# Autodesk Inventor assembly: ASSEMBLY_DUT_Ant_Rotator_REVB
(part 3 of 5)
- Mate:91: 3DP_PLA_A_Axis_Stepper_Mount_REVB:1 ↔ DIN 934 - replaced by DIN EN 24032/28673/28674 M4:10
- Mate:92: 3DP_PLA_A_Axis_Bearing_Base:1 ↔ DIN 934 - replaced by DIN EN 24032/28673/28674 M4:10
- Mate:93: 3DP_PLA_A_Axis_Stepper_Mount_REVB:1 ↔ DIN 934 - replaced by DIN EN 24032/28673/28674 M4:11
- Mate:94: 3DP_PLA_A_Axis_Bearing_Base:1 ↔ DIN 934 - replaced by DIN EN 24032/28673/28674 M4:11
- Angle:18 (0 deg): 3DP_PLA_A_Axis_Bearing_Base:1 ↔ DIN 934 - replaced by DIN EN 24032/28673/28674 M4:9
- Angle:19 (0 deg): 3DP_PLA_A_Axis_Bearing_Base:1 ↔ DIN 934 - replaced by DIN EN 24032/28673/28674 M4:10
- Angle:20 (0 deg): 3DP_PLA_A_Axis_Bearing_Base:1 ↔ DIN 934 - replaced by DIN EN 24032/28673/28674 M4:11
- Mate:95: 3DP_PLA_A_Axis_Stepper_Mount_REVB:1 ↔ ASSEMBLY_HTD3M_Idler_A_Axis:2
- Mate:96: 3DP_PLA_A_Axis_Stepper_Mount_REVB:1 ↔ ASSEMBLY_HTD3M_Idler_A_Axis:1
- Mate:97: 3DP_PLA_A_Axis_Stepper_Mount_REVB:1 ↔ ASSEMBLY_HTD3M_Idler_A_Axis:2
- Mate:98: 3DP_PLA_A_Axis_Stepper_Mount_REVB:1 ↔ ASSEMBLY_HTD3M_Idler_A_Axis:1
- Mate:107: COTS_MKS_SERVO42D_40mm:1 ↔ 3DP_PLA_A_Axis_Stepper_Mount_REVB:1
- Mate:108 (1.6 mm): COTS_MKS_SERVO42D_40mm:1 ↔ 3DP_PLA_A_Axis_Stepper_Mount_REVB:1
- Mate:109 (1.6 mm): COTS_MKS_SERVO42D_40mm:1 ↔ 3DP_PLA_A_Axis_Stepper_Mount_REVB:1
- Mate:110: COTS_MKS_SERVO42D_40mm:1 ↔ DIN 125-1 A A 3,2:1
- Mate:111: 3DP_PLA_A_Axis_Stepper_Mount_REVB:1 ↔ DIN 125-1 A A 3,2:1
- Mate:112: COTS_MKS_SERVO42D_40mm:1 ↔ DIN 125-1 A A 3,2:2
- Mate:113: 3DP_PLA_A_Axis_Stepper_Mount_REVB:1 ↔ DIN 125-1 A A 3,2:2
- Mate:114: COTS_MKS_SERVO42D_40mm:1 ↔ DIN 125-1 A A 3,2:3
- Mate:115: 3DP_PLA_A_Axis_Stepper_Mount_REVB:1 ↔ DIN 125-1 A A 3,2:3
- Mate:116: COTS_MKS_SERVO42D_40mm:1 ↔ DIN 125-1 A A 3,2:4
- Mate:117: 3DP_PLA_A_Axis_Stepper_Mount_REVB:1 ↔ DIN 125-1 A A 3,2:4
- Insert:1: ISO 7380-1 M3 x 16:1 ↔ DIN 125-1 A A 3,2:1
- Insert:2: ISO 7380-1 M3 x 16:2 ↔ DIN 125-1 A A 3,2:2
- Insert:3: ISO 7380-1 M3 x 16:3 ↔ DIN 125-1 A A 3,2:3
- Insert:4: ISO 7380-1 M3 x 16:4 ↔ DIN 125-1 A A 3,2:4
- Mate:118: COTS_GENERIC_HTD3M_24T_6mm_5mm_shaft_pulley:1 ↔ COTS_GENERIC_HTD3M_6mm_675mm_Closed_belt_A_Axis:1
- Mate:119 (0.5 mm): COTS_GENERIC_HTD3M_24T_6mm_5mm_shaft_pulley:1 ↔ COTS_GENERIC_HTD3M_6mm_675mm_Closed_belt_A_Axis:1
- Mate:121: 3DP_PLA_A_Axis_Rotating_Stage:1 ↔ 3DP_PLA_A_Axis_Rotating_Stage_Fiberglass_pipes_mount_plate:1
- Mate:122: 3DP_PLA_A_Axis_Rotating_Stage:1 ↔ 3DP_PLA_A_Axis_Rotating_Stage_Fiberglass_pipes_mount_plate:1
- Mate:123: 3DP_PLA_A_Axis_Rotating_Stage:1 ↔ 3DP_PLA_A_Axis_Rotating_Stage_Fiberglass_pipes_mount_plate:1
- Mate:124: COTS_CARBONCENTER_Fiberglass_Tube_27x24x383mm:1 ↔ 3DP_PLA_A_Axis_Rotating_Stage_Fiberglass_pipes_mount_plate:1
- Flush:1: COTS_CARBONCENTER_Fiberglass_Tube_27x24x383mm:1 ↔ 3DP_PLA_A_Axis_Rotating_Stage_Fiberglass_pipes_mount_plate:1
- Mate:125: 3DP_PLA_A_Axis_Rotating_Stage_Fiberglass_pipes_mount_plate:1 ↔ COTS_CARBONCENTER_Fiberglass_Tube_27x24x383mm:2
- Flush:2: 3DP_PLA_A_Axis_Rotating_Stage_Fiberglass_pipes_mount_plate:1 ↔ COTS_CARBONCENTER_Fiberglass_Tube_27x24x383mm:2
- Mate:127 (1 mm): 3DP_PLA_A_Axis_Rotating_Stage_Fiberglass_pipes_mount_plate:1 ↔ 3DP_PLA_A_Axis_Rotating_Stage_Fiberglass_pipes_mount_clamp:2
- Mate:128 (1 mm): 3DP_PLA_A_Axis_Rotating_Stage_Fiberglass_pipes_mount_plate:1 ↔ 3DP_PLA_A_Axis_Rotating_Stage_Fiberglass_pipes_mount_clamp:1
- Flush:3: 3DP_PLA_A_Axis_Rotating_Stage_Fiberglass_pipes_mount_plate:1 ↔ 3DP_PLA_A_Axis_Rotating_Stage_Fiberglass_pipes_mount_clamp:2
- Flush:4: 3DP_PLA_A_Axis_Rotating_Stage_Fiberglass_pipes_mount_plate:1 ↔ 3DP_PLA_A_Axis_Rotating_Stage_Fiberglass_pipes_mount_clamp:2
- Flush:5: 3DP_PLA_A_Axis_Rotating_Stage_Fiberglass_pipes_mount_plate:1 ↔ 3DP_PLA_A_Axis_Rotating_Stage_Fiberglass_pipes_mount_clamp:1
- Flush:6: 3DP_PLA_A_Axis_Rotating_Stage_Fiberglass_pipes_mount_plate:1 ↔ 3DP_PLA_A_Axis_Rotating_Stage_Fiberglass_pipes_mount_clamp:1
- Mate:129: 3DP_PLA_A_Axis_Rotating_Stage_Fiberglass_pipes_mount_clamp:2 ↔ DIN 912 - replaced by DIN EN ISO 4762 M5 x 50:9
- Mate:130: 3DP_PLA_A_Axis_Rotating_Stage_Fiberglass_pipes_mount_clamp:2 ↔ DIN 912 - replaced by DIN EN ISO 4762 M5 x 50:9
- Mate:131: 3DP_PLA_A_Axis_Rotating_Stage_Fiberglass_pipes_mount_clamp:2 ↔ DIN 912 - replaced by DIN EN ISO 4762 M5 x 50:10
- Mate:132: 3DP_PLA_A_Axis_Rotating_Stage_Fiberglass_pipes_mount_clamp:2 ↔ DIN 912 - replaced by DIN EN ISO 4762 M5 x 50:10
- Mate:133: 3DP_PLA_A_Axis_Rotating_Stage_Fiberglass_pipes_mount_clamp:2 ↔ DIN 912 - replaced by DIN EN ISO 4762 M5 x 50:11
- Mate:134: 3DP_PLA_A_Axis_Rotating_Stage_Fiberglass_pipes_mount_clamp:2 ↔ DIN 912 - replaced by DIN EN ISO 4762 M5 x 50:11
- Mate:135: 3DP_PLA_A_Axis_Rotating_Stage_Fiberglass_pipes_mount_clamp:2 ↔ DIN 912 - replaced by DIN EN ISO 4762 M5 x 50:12
- Mate:136: 3DP_PLA_A_Axis_Rotating_Stage_Fiberglass_pipes_mount_clamp:2 ↔ DIN 912 - replaced by DIN EN ISO 4762 M5 x 50:12
- Mate:137: 3DP_PLA_A_Axis_Rotating_Stage_Fiberglass_pipes_mount_clamp:2 ↔ DIN 912 - replaced by DIN EN ISO 4762 M5 x 50:13
- Mate:138: 3DP_PLA_A_Axis_Rotating_Stage_Fiberglass_pipes_mount_clamp:2 ↔ DIN 912 - replaced by DIN EN ISO 4762 M5 x 50:13
- Mate:139: 3DP_PLA_A_Axis_Rotating_Stage_Fiberglass_pipes_mount_clamp:2 ↔ DIN 912 - replaced by DIN EN ISO 4762 M5 x 50:14
- Mate:140: 3DP_PLA_A_Axis_Rotating_Stage_Fiberglass_pipes_mount_clamp:2 ↔ DIN 912 - replaced by DIN EN ISO 4762 M5 x 50:14
- Mate:141: 3DP_PLA_A_Axis_Rotating_Stage_Fiberglass_pipes_mount_clamp:1 ↔ DIN 912 - replaced by DIN EN ISO 4762 M5 x 50:15
- Mate:142: 3DP_PLA_A_Axis_Rotating_Stage_Fiberglass_pipes_mount_clamp:2 ↔ DIN 912 - replaced by DIN EN ISO 4762 M5 x 50:15
- Mate:143: 3DP_PLA_A_Axis_Rotating_Stage_Fiberglass_pipes_mount_clamp:1 ↔ DIN 912 - replaced by DIN EN ISO 4762 M5 x 50:16
- Mate:144: 3DP_PLA_A_Axis_Rotating_Stage_Fiberglass_pipes_mount_clamp:2 ↔ DIN 912 - replaced by DIN EN ISO 4762 M5 x 50:16
- Mate:145: 3DP_PLA_A_Axis_Rotating_Stage_Fiberglass_pipes_mount_clamp:1 ↔ DIN 912 - replaced by DIN EN ISO 4762 M5 x 50:17
- Mate:146: 3DP_PLA_A_Axis_Rotating_Stage_Fiberglass_pipes_mount_clamp:2 ↔ DIN 912 - replaced by DIN EN ISO 4762 M5 x 50:17
- Mate:147: 3DP_PLA_A_Axis_Rotating_Stage_Fiberglass_pipes_mount_clamp:1 ↔ DIN 912 - replaced by DIN EN ISO 4762 M5 x 50:18
- Mate:148: 3DP_PLA_A_Axis_Rotating_Stage_Fiberglass_pipes_mount_clamp:2 ↔ DIN 912 - replaced by DIN EN ISO 4762 M5 x 50:18
- Mate:149: 3DP_PLA_A_Axis_Rotating_Stage_Fiberglass_pipes_mount_clamp:1 ↔ DIN 912 - replaced by DIN EN ISO 4762 M5 x 50:19
- Mate:150: 3DP_PLA_A_Axis_Rotating_Stage_Fiberglass_pipes_mount_clamp:2 ↔ DIN 912 - replaced by DIN EN ISO 4762 M5 x 50:19
- Mate:151: 3DP_PLA_A_Axis_Rotating_Stage_Fiberglass_pipes_mount_clamp:1 ↔ DIN 912 - replaced by DIN EN ISO 4762 M5 x 50:20
- Mate:152: 3DP_PLA_A_Axis_Rotating_Stage_Fiberglass_pipes_mount_clamp:2 ↔ DIN 912 - replaced by DIN EN ISO 4762 M5 x 50:20
- Mate:153: 3DP_PLA_A_Axis_Rotating_Stage_Fiberglass_pipes_mount_clamp:2 ↔ DIN 934 - replaced by DIN EN 24032/28673/28674 M5:9
- Mate:154: 3DP_PLA_A_Axis_Rotating_Stage_Fiberglass_pipes_mount_plate:1 ↔ DIN 934 - replaced by DIN EN 24032/28673/28674 M5:9
- Mate:155: 3DP_PLA_A_Axis_Rotating_Stage_Fiberglass_pipes_mount_clamp:2 ↔ DIN 934 - replaced by DIN EN 24032/28673/28674 M5:10
- Mate:156: 3DP_PLA_A_Axis_Rotating_Stage_Fiberglass_pipes_mount_plate:1 ↔ DIN 934 - replaced by DIN EN 24032/28673/28674 M5:10
- Mate:157: 3DP_PLA_A_Axis_Rotating_Stage_Fiberglass_pipes_mount_clamp:2 ↔ DIN 934 - replaced by DIN EN 24032/28673/28674 M5:11
- Mate:158: 3DP_PLA_A_Axis_Rotating_Stage_Fiberglass_pipes_mount_plate:1 ↔ DIN 934 - replaced by DIN EN 24032/28673/28674 M5:11
- Mate:159: 3DP_PLA_A_Axis_Rotating_Stage_Fiberglass_pipes_mount_clamp:2 ↔ DIN 934 - replaced by DIN EN 24032/28673/28674 M5:12
- Mate:160: 3DP_PLA_A_Axis_Rotating_Stage_Fiberglass_pipes_mount_plate:1 ↔ DIN 934 - replaced by DIN EN 24032/28673/28674 M5:12
- Mate:161: 3DP_PLA_A_Axis_Rotating_Stage_Fiberglass_pipes_mount_clamp:2 ↔ DIN 934 - replaced by DIN EN 24032/28673/28674 M5:13
- Mate:162: 3DP_PLA_A_Axis_Rotating_Stage_Fiberglass_pipes_mount_plate:1 ↔ DIN 934 - replaced by DIN EN 24032/28673/28674 M5:13
- Mate:163: 3DP_PLA_A_Axis_Rotating_Stage_Fiberglass_pipes_mount_clamp:2 ↔ DIN 934 - replaced by DIN EN 24032/28673/28674 M5:14
- Mate:164: 3DP_PLA_A_Axis_Rotating_Stage_Fiberglass_pipes_mount_plate:1 ↔ DIN 934 - replaced by DIN EN 24032/28673/28674 M5:14
- Mate:165: 3DP_PLA_A_Axis_Rotating_Stage_Fiberglass_pipes_mount_clamp:1 ↔ DIN 934 - replaced by DIN EN 24032/28673/28674 M5:15
- Mate:166: 3DP_PLA_A_Axis_Rotating_Stage_Fiberglass_pipes_mount_plate:1 ↔ DIN 934 - replaced by DIN EN 24032/28673/28674 M5:15
- Mate:167: 3DP_PLA_A_Axis_Rotating_Stage_Fiberglass_pipes_mount_clamp:1 ↔ DIN 934 - replaced by DIN EN 24032/28673/28674 M5:16
- Mate:168: 3DP_PLA_A_Axis_Rotating_Stage_Fiberglass_pipes_mount_plate:1 ↔ DIN 934 - replaced by DIN EN 24032/28673/28674 M5:16
- Mate:169: 3DP_PLA_A_Axis_Rotating_Stage_Fiberglass_pipes_mount_clamp:1 ↔ DIN 934 - replaced by DIN EN 24032/28673/28674 M5:17
- Mate:170: 3DP_PLA_A_Axis_Rotating_Stage_Fiberglass_pipes_mount_plate:1 ↔ DIN 934 - replaced by DIN EN 24032/28673/28674 M5:17
- Mate:171: 3DP_PLA_A_Axis_Rotating_Stage_Fiberglass_pipes_mount_clamp:1 ↔ DIN 934 - replaced by DIN EN 24032/28673/28674 M5:18
- Mate:172: 3DP_PLA_A_Axis_Rotating_Stage_Fiberglass_pipes_mount_plate:1 ↔ DIN 934 - replaced by DIN EN 24032/28673/28674 M5:18
- Mate:173: 3DP_PLA_A_Axis_Rotating_Stage_Fiberglass_pipes_mount_clamp:1 ↔ DIN 934 - replaced by DIN EN 24032/28673/28674 M5:19
- Mate:174: 3DP_PLA_A_Axis_Rotating_Stage_Fiberglass_pipes_mount_plate:1 ↔ DIN 934 - replaced by DIN EN 24032/28673/28674 M5:19
- Mate:175: 3DP_PLA_A_Axis_Rotating_Stage_Fiberglass_pipes_mount_clamp:1 ↔ DIN 934 - replaced by DIN EN 24032/28673/28674 M5:20
- Mate:176: 3DP_PLA_A_Axis_Rotating_Stage_Fiberglass_pipes_mount_plate:1 ↔ DIN 934 - replaced by DIN EN 24032/28673/28674 M5:20
- Angle:21 (0 deg): 3DP_PLA_A_Axis_Rotating_Stage_Fiberglass_pipes_mount_plate:1 ↔ DIN 934 - replaced by DIN EN 24032/28673/28674 M5:9
- Angle:22 (0 deg): 3DP_PLA_A_Axis_Rotating_Stage_Fiberglass_pipes_mount_plate:1 ↔ DIN 934 - replaced by DIN EN 24032/28673/28674 M5:12
- Angle:23 (0 deg): 3DP_PLA_A_Axis_Rotating_Stage_Fiberglass_pipes_mount_plate:1 ↔ DIN 934 - replaced by DIN EN 24032/28673/28674 M5:13
- Angle:24 (0 deg): 3DP_PLA_A_Axis_Rotating_Stage_Fiberglass_pipes_mount_plate:1 ↔ DIN 934 - replaced by DIN EN 24032/28673/28674 M5:14
- Angle:25 (0 deg): 3DP_PLA_A_Axis_Rotating_Stage_Fiberglass_pipes_mount_plate:1 ↔ DIN 934 - replaced by DIN EN 24032/28673/28674 M5:11
- Angle:26 (0 deg): 3DP_PLA_A_Axis_Rotating_Stage_Fiberglass_pipes_mount_plate:1 ↔ DIN 934 - replaced by DIN EN 24032/28673/28674 M5:10
- Angle:27 (0 deg): 3DP_PLA_A_Axis_Rotating_Stage_Fiberglass_pipes_mount_plate:1 ↔ DIN 934 - replaced by DIN EN 24032/28673/28674 M5:20
- Angle:28 (0 deg): 3DP_PLA_A_Axis_Rotating_Stage_Fiberglass_pipes_mount_plate:1 ↔ DIN 934 - replaced by DIN EN 24032/28673/28674 M5:19
- Angle:29 (0 deg): 3DP_PLA_A_Axis_Rotating_Stage_Fiberglass_pipes_mount_plate:1 ↔ DIN 934 - replaced by DIN EN 24032/28673/28674 M5:18
- Angle:30 (0 deg): 3DP_PLA_A_Axis_Rotating_Stage_Fiberglass_pipes_mount_plate:1 ↔ DIN 934 - replaced by DIN EN 24032/28673/28674 M5:17
- Angle:31 (0 deg): 3DP_PLA_A_Axis_Rotating_Stage_Fiberglass_pipes_mount_plate:1 ↔ DIN 934 - replaced by DIN EN 24032/28673/28674 M5:16
- Angle:32 (0 deg): 3DP_PLA_A_Axis_Rotating_Stage_Fiberglass_pipes_mount_plate:1 ↔ DIN 934 - replaced by DIN EN 24032/28673/28674 M5:15
- Mate:177: 3DP_PLA_A_Axis_Rotating_Stage_Fiberglass_pipes_mount_plate:1 ↔ DIN 912 - replaced by DIN EN ISO 4762 M4 x 20:1
- Mate:178: 3DP_PLA_A_Axis_Rotating_Stage_Fiberglass_pipes_mount_plate:1 ↔ DIN 912 - replaced by DIN EN ISO 4762 M4 x 20:1
- Mate:179: 3DP_PLA_A_Axis_Rotating_Stage_Fiberglass_pipes_mount_plate:1 ↔ DIN 912 - replaced by DIN EN ISO 4762 M4 x 20:2
- Mate:180: 3DP_PLA_A_Axis_Rotating_Stage_Fiberglass_pipes_mount_plate:1 ↔ DIN 912 - replaced by DIN EN ISO 4762 M4 x 20:2
- Mate:181: 3DP_PLA_A_Axis_Rotating_Stage_Fiberglass_pipes_mount_plate:1 ↔ DIN 912 - replaced by DIN EN ISO 4762 M4 x 20:3
- Mate:182: 3DP_PLA_A_Axis_Rotating_Stage_Fiberglass_pipes_mount_plate:1 ↔ DIN 912 - replaced by DIN EN ISO 4762 M4 x 20:3
- Mate:183: 3DP_PLA_A_Axis_Rotating_Stage_Fiberglass_pipes_mount_plate:1 ↔ DIN 912 - replaced by DIN EN ISO 4762 M4 x 20:4
- Mate:184: 3DP_PLA_A_Axis_Rotating_Stage_Fiberglass_pipes_mount_plate:1 ↔ DIN 912 - replaced by DIN EN ISO 4762 M4 x 20:4
- Mate:185: 3DP_PLA_A_Axis_Rotating_Stage_Fiberglass_pipes_mount_plate:1 ↔ DIN 912 - replaced by DIN EN ISO 4762 M4 x 20:5
- Mate:186: 3DP_PLA_A_Axis_Rotating_Stage_Fiberglass_pipes_mount_plate:1 ↔ DIN 912 - replaced by DIN EN ISO 4762 M4 x 20:5
- Mate:187: 3DP_PLA_A_Axis_Rotating_Stage_Fiberglass_pipes_mount_plate:1 ↔ DIN 912 - replaced by DIN EN ISO 4762 M4 x 20:6
- Mate:188: 3DP_PLA_A_Axis_Rotating_Stage_Fiberglass_pipes_mount_plate:1 ↔ DIN 912 - replaced by DIN EN ISO 4762 M4 x 20:6
- Mate:189: 3DP_PLA_A_Axis_Rotating_Stage_Fiberglass_pipes_mount_plate:1 ↔ DIN 912 - replaced by DIN EN ISO 4762 M4 x 20:7
- Mate:190: 3DP_PLA_A_Axis_Rotating_Stage_Fiberglass_pipes_mount_plate:1 ↔ DIN 912 - replaced by DIN EN ISO 4762 M4 x 20:7
- Mate:191: 3DP_PLA_A_Axis_Rotating_Stage_Fiberglass_pipes_mount_plate:1 ↔ DIN 912 - replaced by DIN EN ISO 4762 M4 x 20:8
- Mate:192: 3DP_PLA_A_Axis_Rotating_Stage_Fiberglass_pipes_mount_plate:1 ↔ DIN 912 - replaced by DIN EN ISO 4762 M4 x 20:8
- Mate:193: 3DP_PLA_A_Axis_Rotating_Stage_Fiberglass_pipes_mount_plate:1 ↔ DIN 934 - replaced by DIN EN 24032/28673/28674 M4:14
- Mate:194: 3DP_PLA_A_Axis_Rotating_Stage:1 ↔ DIN 934 - replaced by DIN EN 24032/28673/28674 M4:14
- Mate:195: 3DP_PLA_A_Axis_Rotating_Stage_Fiberglass_pipes_mount_plate:1 ↔ DIN 934 - replaced by DIN EN 24032/28673/28674 M4:15
- Mate:196: 3DP_PLA_A_Axis_Rotating_Stage:1 ↔ DIN 934 - replaced by DIN EN 24032/28673/28674 M4:15
- Mate:197: 3DP_PLA_A_Axis_Rotating_Stage_Fiberglass_pipes_mount_plate:1 ↔ DIN 934 - replaced by DIN EN 24032/28673/28674 M4:16
- Mate:198: 3DP_PLA_A_Axis_Rotating_Stage:1 ↔ DIN 934 - replaced by DIN EN 24032/28673/28674 M4:16
- Mate:199: 3DP_PLA_A_Axis_Rotating_Stage_Fiberglass_pipes_mount_plate:1 ↔ DIN 934 - replaced by DIN EN 24032/28673/28674 M4:17
- Mate:200: 3DP_PLA_A_Axis_Rotating_Stage:1 ↔ DIN 934 - replaced by DIN EN 24032/28673/28674 M4:17
- Mate:201: 3DP_PLA_A_Axis_Rotating_Stage_Fiberglass_pipes_mount_plate:1 ↔ DIN 934 - replaced by DIN EN 24032/28673/28674 M4:18
- Mate:202: 3DP_PLA_A_Axis_Rotating_Stage:1 ↔ DIN 934 - replaced by DIN EN 24032/28673/28674 M4:18
- Mate:203: 3DP_PLA_A_Axis_Rotating_Stage_Fiberglass_pipes_mount_plate:1 ↔ DIN 934 - replaced by DIN EN 24032/28673/28674 M4:19
- Mate:204: 3DP_PLA_A_Axis_Rotating_Stage:1 ↔ DIN 934 - replaced by DIN EN 24032/28673/28674 M4:19
- Mate:205: 3DP_PLA_A_Axis_Rotating_Stage_Fiberglass_pipes_mount_plate:1 ↔ DIN 934 - replaced by DIN EN 24032/28673/28674 M4:20
- Mate:206: 3DP_PLA_A_Axis_Rotating_Stage:1 ↔ DIN 934 - replaced by DIN EN 24032/28673/28674 M4:20
- Mate:207: 3DP_PLA_A_Axis_Rotating_Stage_Fiberglass_pipes_mount_plate:1 ↔ DIN 934 - replaced by DIN EN 24032/28673/28674 M4:21
- Mate:208: 3DP_PLA_A_Axis_Rotating_Stage:1 ↔ DIN 934 - replaced by DIN EN 24032/28673/28674 M4:21
- Angle:33 (0 deg): 3DP_PLA_A_Axis_Rotating_Stage:1 ↔ DIN 934 - replaced by DIN EN 24032/28673/28674 M4:17
- Angle:34 (0 deg): 3DP_PLA_A_Axis_Rotating_Stage:1 ↔ DIN 934 - replaced by DIN EN 24032/28673/28674 M4:15
- Angle:35 (0 deg): 3DP_PLA_A_Axis_Rotating_Stage:1 ↔ DIN 934 - replaced by DIN EN 24032/28673/28674 M4:14
- Angle:36 (0 deg): 3DP_PLA_A_Axis_Rotating_Stage:1 ↔ DIN 934 - replaced by DIN EN 24032/28673/28674 M4:16
- Angle:37 (0 deg): 3DP_PLA_A_Axis_Rotating_Stage:1 ↔ DIN 934 - replaced by DIN EN 24032/28673/28674 M4:21
- Angle:38 (0 deg): 3DP_PLA_A_Axis_Rotating_Stage:1 ↔ DIN 934 - replaced by DIN EN 24032/28673/28674 M4:20
- Angle:39 (0 deg): 3DP_PLA_A_Axis_Rotating_Stage:1 ↔ DIN 934 - replaced by DIN EN 24032/28673/28674 M4:19
- Angle:40 (0 deg): 3DP_PLA_A_Axis_Rotating_Stage:1 ↔ DIN 934 - replaced by DIN EN 24032/28673/28674 M4:18
- Angle:41 (0 deg): 3DP_PLA_A_Axis_Rotating_Stage_Fiberglass_pipes_mount_plate:1
- Mate:209: COTS_CARBONCENTER_Fiberglass_Tube_27x24x383mm:2 ↔ 3DP_PLA_Fiberglass_Pipe_Corner_Bracket:1
- Mate:210: COTS_CARBONCENTER_Fiberglass_Tube_27x24x383mm:1 ↔ 3DP_PLA_Fiberglass_Pipe_Corner_Bracket:1
- Mate:211: COTS_CARBONCENTER_Fiberglass_Tube_27x24x383mm:3 ↔ 3DP_PLA_Fiberglass_Pipe_Corner_Bracket:1
- Mate:212: COTS_CARBONCENTER_Fiberglass_Tube_27x24x383mm:4 ↔ 3DP_PLA_Fiberglass_Pipe_Corner_Bracket:1
- Mate:213: COTS_CARBONCENTER_Fiberglass_Tube_27x24x383mm:2 ↔ 3DP_PLA_Fiberglass_Pipe_Corner_Bracket_Clamp:1
- Mate:214: COTS_CARBONCENTER_Fiberglass_Tube_27x24x383mm:1 ↔ 3DP_PLA_Fiberglass_Pipe_Corner_Bracket_Clamp:1
- Mate:215: 3DP_PLA_Fiberglass_Pipe_Corner_Bracket:1 ↔ 3DP_PLA_Fiberglass_Pipe_Corner_Bracket_Clamp:1
- Mate:216: 3DP_PLA_Fiberglass_Pipe_Corner_Bracket_Clamp:1 ↔ COTS_DREMEC_8G206M6X50_M6x50_Nylon_Screw:3
- Mate:217: 3DP_PLA_Fiberglass_Pipe_Corner_Bracket_Clamp:1 ↔ COTS_DREMEC_8G206M6X50_M6x50_Nylon_Screw:1
- Mate:218: 3DP_PLA_Fiberglass_Pipe_Corner_Bracket_Clamp:1 ↔ COTS_DREMEC_8G206M6X50_M6x50_Nylon_Screw:2
- Mate:219: 3DP_PLA_Fiberglass_Pipe_Corner_Bracket_Clamp:1 ↔ COTS_DREMEC_8G206M6X50_M6x50_Nylon_Screw:4
- Mate:220: 3DP_PLA_Fiberglass_Pipe_Corner_Bracket_Clamp:1 ↔ COTS_DREMEC_8G206M6X50_M6x50_Nylon_Screw:5
- Mate:221: 3DP_PLA_Fiberglass_Pipe_Corner_Bracket_Clamp:1 ↔ COTS_DREMEC_8G206M6X50_M6x50_Nylon_Screw:6
- Mate:222: 3DP_PLA_Fiberglass_Pipe_Corner_Bracket_Clamp:1 ↔ COTS_DREMEC_8G206M6X50_M6x50_Nylon_Screw:1
- Mate:223: 3DP_PLA_Fiberglass_Pipe_Corner_Bracket_Clamp:1 ↔ COTS_DREMEC_8G206M6X50_M6x50_Nylon_Screw:3
- Mate:224: 3DP_PLA_Fiberglass_Pipe_Corner_Bracket_Clamp:1 ↔ COTS_DREMEC_8G206M6X50_M6x50_Nylon_Screw:2
- Mate:225: 3DP_PLA_Fiberglass_Pipe_Corner_Bracket_Clamp:1 ↔ COTS_DREMEC_8G206M6X50_M6x50_Nylon_Screw:4
- Mate:226: 3DP_PLA_Fiberglass_Pipe_Corner_Bracket_Clamp:1 ↔ COTS_DREMEC_8G206M6X50_M6x50_Nylon_Screw:5
- Mate:227: 3DP_PLA_Fiberglass_Pipe_Corner_Bracket_Clamp:1 ↔ COTS_DREMEC_8G206M6X50_M6x50_Nylon_Screw:6
- Flush:7: COTS_CARBONCENTER_Fiberglass_Tube_27x24x383mm:2 ↔ 3DP_PLA_Fiberglass_Pipe_Corner_Bracket_Clamp:1
- Mate:228: 3DP_PLA_Fiberglass_Pipe_Corner_Bracket:1 ↔ COTS_BOSSARD_1400444_M6_Nylon_Nut:1
- Mate:229: 3DP_PLA_Fiberglass_Pipe_Corner_Bracket:1 ↔ COTS_BOSSARD_1400444_M6_Nylon_Nut:2
- Mate:230: 3DP_PLA_Fiberglass_Pipe_Corner_Bracket:1 ↔ COTS_BOSSARD_1400444_M6_Nylon_Nut:5
- Mate:231: 3DP_PLA_Fiberglass_Pipe_Corner_Bracket:1 ↔ COTS_BOSSARD_1400444_M6_Nylon_Nut:4
- Mate:232: 3DP_PLA_Fiberglass_Pipe_Corner_Bracket:1 ↔ COTS_BOSSARD_1400444_M6_Nylon_Nut:3
- Mate:233: 3DP_PLA_Fiberglass_Pipe_Corner_Bracket:1 ↔ COTS_BOSSARD_1400444_M6_Nylon_Nut:6
- Mate:234: COTS_BOSSARD_1400444_M6_Nylon_Nut:1 ↔ COTS_DREMEC_8G206M6X50_M6x50_Nylon_Screw:3
- Mate:235: COTS_BOSSARD_1400444_M6_Nylon_Nut:2 ↔ COTS_DREMEC_8G206M6X50_M6x50_Nylon_Screw:1
- Mate:236: COTS_BOSSARD_1400444_M6_Nylon_Nut:4 ↔ COTS_DREMEC_8G206M6X50_M6x50_Nylon_Screw:4
- Mate:237: COTS_BOSSARD_1400444_M6_Nylon_Nut:5 ↔ COTS_DREMEC_8G206M6X50_M6x50_Nylon_Screw:2
- Mate:238: COTS_BOSSARD_1400444_M6_Nylon_Nut:3 ↔ COTS_DREMEC_8G206M6X50_M6x50_Nylon_Screw:5
- Mate:239: COTS_BOSSARD_1400444_M6_Nylon_Nut:6 ↔ COTS_DREMEC_8G206M6X50_M6x50_Nylon_Screw:6
- Mate:240 (-83.25 mm): COTS_CARBONCENTER_Fiberglass_Tube_27x24x383mm:3 ↔ 3DP_PLA_Fiberglass_Pipe_Corner_Bracket:1
- Mate:241 (-83.25 mm): COTS_CARBONCENTER_Fiberglass_Tube_27x24x383mm:4 ↔ 3DP_PLA_Fiberglass_Pipe_Corner_Bracket:1
- Mate:242: COTS_CARBONCENTER_Fiberglass_Tube_27x24x383mm:3 ↔ 3DP_PLA_Fiberglass_Pipe_Corner_Bracket_Clamp_and_B_axis_Stepper_Mount_REVB:1
- Mate:243: COTS_CARBONCENTER_Fiberglass_Tube_27x24x383mm:4 ↔ 3DP_PLA_Fiberglass_Pipe_Corner_Bracket_Clamp_and_B_axis_Stepper_Mount_REVB:1
- Mate:244: 3DP_PLA_Fiberglass_Pipe_Corner_Bracket:1 ↔ 3DP_PLA_Fiberglass_Pipe_Corner_Bracket_Clamp_and_B_axis_Stepper_Mount_REVB:1
- Mate:245: 3DP_PLA_Fiberglass_Pipe_Corner_Bracket_Clamp_and_B_axis_Stepper_Mount_REVB:1 ↔ COTS_MKS_SERVO42D_40mm:2
- Mate:247: COTS_MKS_SERVO42D_40mm:2 ↔ COTS_GENERIC_HTD3M_20T_6mm_5mm_shaft_pulley:1
- Mate:248 (1.6 mm): 3DP_PLA_Fiberglass_Pipe_Corner_Bracket_Clamp_and_B_axis_Stepper_Mount_REVB:1 ↔ COTS_MKS_SERVO42D_40mm:2
- Mate:249 (1.6 mm): 3DP_PLA_Fiberglass_Pipe_Corner_Bracket_Clamp_and_B_axis_Stepper_Mount_REVB:1 ↔ COTS_MKS_SERVO42D_40mm:2
- Flush:8 (-11.5 mm): 3DP_PLA_Fiberglass_Pipe_Corner_Bracket_Clamp_and_B_axis_Stepper_Mount_REVB:1 ↔ COTS_GENERIC_HTD3M_20T_6mm_5mm_shaft_pulley:1
- Mate:250: COTS_CARBONCENTER_Fiberglass_Tube_27x24x383mm:6 ↔ 3DP_PLA_Fiberglass_Pipe_Corner_Bracket:2
- Mate:251: COTS_CARBONCENTER_Fiberglass_Tube_27x24x383mm:5 ↔ 3DP_PLA_Fiberglass_Pipe_Corner_Bracket:2
- Mate:252: COTS_CARBONCENTER_Fiberglass_Tube_27x24x383mm:8 ↔ 3DP_PLA_Fiberglass_Pipe_Corner_Bracket:2
- Mate:253: COTS_CARBONCENTER_Fiberglass_Tube_27x24x383mm:7 ↔ 3DP_PLA_Fiberglass_Pipe_Corner_Bracket:2
- Mate:254: COTS_CARBONCENTER_Fiberglass_Tube_27x24x383mm:5 ↔ 3DP_PLA_Fiberglass_Pipe_Corner_Bracket_Clamp:2
- Mate:255: COTS_CARBONCENTER_Fiberglass_Tube_27x24x383mm:6 ↔ 3DP_PLA_Fiberglass_Pipe_Corner_Bracket_Clamp:2
- Mate:256: COTS_CARBONCENTER_Fiberglass_Tube_27x24x383mm:7 ↔ 3DP_PLA_Fiberglass_Pipe_Corner_Bracket_Clamp:3
- Mate:257: COTS_CARBONCENTER_Fiberglass_Tube_27x24x383mm:8 ↔ 3DP_PLA_Fiberglass_Pipe_Corner_Bracket_Clamp:3
- Flush:9: 3DP_PLA_Fiberglass_Pipe_Corner_Bracket:2 ↔ 3DP_PLA_Fiberglass_Pipe_Corner_Bracket_Clamp:3
- Flush:10: 3DP_PLA_Fiberglass_Pipe_Corner_Bracket:2 ↔ 3DP_PLA_Fiberglass_Pipe_Corner_Bracket_Clamp:2
- Flush:11: COTS_CARBONCENTER_Fiberglass_Tube_27x24x383mm:5 ↔ 3DP_PLA_Fiberglass_Pipe_Corner_Bracket_Clamp:2
- Flush:12: COTS_CARBONCENTER_Fiberglass_Tube_27x24x383mm:6 ↔ 3DP_PLA_Fiberglass_Pipe_Corner_Bracket_Clamp:2
- Flush:13: COTS_CARBONCENTER_Fiberglass_Tube_27x24x383mm:7 ↔ 3DP_PLA_Fiberglass_Pipe_Corner_Bracket_Clamp:3
- Flush:14: COTS_CARBONCENTER_Fiberglass_Tube_27x24x383mm:8 ↔ 3DP_PLA_Fiberglass_Pipe_Corner_Bracket_Clamp:3
- Mate:258: 3DP_PLA_Fiberglass_Pipe_Corner_Bracket_Clamp_and_B_axis_Stepper_Mount_REVB:1 ↔ COTS_DREMEC_8G206M6X50_M6x50_Nylon_Screw:7
- Mate:259: 3DP_PLA_Fiberglass_Pipe_Corner_Bracket_Clamp_and_B_axis_Stepper_Mount_REVB:1 ↔ COTS_DREMEC_8G206M6X50_M6x50_Nylon_Screw:8
- Mate:260: 3DP_PLA_Fiberglass_Pipe_Corner_Bracket_Clamp_and_B_axis_Stepper_Mount_REVB:1 ↔ COTS_DREMEC_8G206M6X50_M6x50_Nylon_Screw:9
- Mate:261: 3DP_PLA_Fiberglass_Pipe_Corner_Bracket_Clamp_and_B_axis_Stepper_Mount_REVB:1 ↔ COTS_DREMEC_8G206M6X50_M6x50_Nylon_Screw:10
- Mate:262: 3DP_PLA_Fiberglass_Pipe_Corner_Bracket_Clamp_and_B_axis_Stepper_Mount_REVB:1 ↔ COTS_DREMEC_8G206M6X50_M6x50_Nylon_Screw:11
- Mate:263: 3DP_PLA_Fiberglass_Pipe_Corner_Bracket_Clamp_and_B_axis_Stepper_Mount_REVB:1 ↔ COTS_DREMEC_8G206M6X50_M6x50_Nylon_Screw:12
- Mate:264: 3DP_PLA_Fiberglass_Pipe_Corner_Bracket_Clamp_and_B_axis_Stepper_Mount_REVB:1 ↔ COTS_DREMEC_8G206M6X50_M6x50_Nylon_Screw:9
- Mate:265: 3DP_PLA_Fiberglass_Pipe_Corner_Bracket_Clamp_and_B_axis_Stepper_Mount_REVB:1 ↔ COTS_DREMEC_8G206M6X50_M6x50_Nylon_Screw:11
- Mate:266: 3DP_PLA_Fiberglass_Pipe_Corner_Bracket_Clamp_and_B_axis_Stepper_Mount_REVB:1 ↔ COTS_DREMEC_8G206M6X50_M6x50_Nylon_Screw:8
- Mate:267: 3DP_PLA_Fiberglass_Pipe_Corner_Bracket_Clamp_and_B_axis_Stepper_Mount_REVB:1 ↔ COTS_DREMEC_8G206M6X50_M6x50_Nylon_Screw:7
- Mate:268: 3DP_PLA_Fiberglass_Pipe_Corner_Bracket_Clamp_and_B_axis_Stepper_Mount_REVB:1 ↔ COTS_DREMEC_8G206M6X50_M6x50_Nylon_Screw:12
- Mate:269: 3DP_PLA_Fiberglass_Pipe_Corner_Bracket_Clamp_and_B_axis_Stepper_Mount_REVB:1 ↔ COTS_DREMEC_8G206M6X50_M6x50_Nylon_Screw:10
- Mate:270: 3DP_PLA_Fiberglass_Pipe_Corner_Bracket:1 ↔ COTS_BOSSARD_1400444_M6_Nylon_Nut:12
- Mate:271: 3DP_PLA_Fiberglass_Pipe_Corner_Bracket:1 ↔ COTS_BOSSARD_1400444_M6_Nylon_Nut:11
- Mate:272: 3DP_PLA_Fiberglass_Pipe_Corner_Bracket:1 ↔ COTS_BOSSARD_1400444_M6_Nylon_Nut:10
- Mate:273: 3DP_PLA_Fiberglass_Pipe_Corner_Bracket:1 ↔ COTS_BOSSARD_1400444_M6_Nylon_Nut:9
- Mate:274: 3DP_PLA_Fiberglass_Pipe_Corner_Bracket:1 ↔ COTS_BOSSARD_1400444_M6_Nylon_Nut:7
- Mate:275: 3DP_PLA_Fiberglass_Pipe_Corner_Bracket:1 ↔ COTS_BOSSARD_1400444_M6_Nylon_Nut:8
- Mate:276: COTS_BOSSARD_1400444_M6_Nylon_Nut:8 ↔ COTS_DREMEC_8G206M6X50_M6x50_Nylon_Screw:8
- Mate:277: COTS_BOSSARD_1400444_M6_Nylon_Nut:7 ↔ COTS_DREMEC_8G206M6X50_M6x50_Nylon_Screw:7
- Mate:278: COTS_BOSSARD_1400444_M6_Nylon_Nut:10 ↔ COTS_DREMEC_8G206M6X50_M6x50_Nylon_Screw:12
- Mate:279: COTS_BOSSARD_1400444_M6_Nylon_Nut:9 ↔ COTS_DREMEC_8G206M6X50_M6x50_Nylon_Screw:11
- Mate:280: COTS_BOSSARD_1400444_M6_Nylon_Nut:12 ↔ COTS_DREMEC_8G206M6X50_M6x50_Nylon_Screw:10
- Mate:281: COTS_BOSSARD_1400444_M6_Nylon_Nut:11 ↔ COTS_DREMEC_8G206M6X50_M6x50_Nylon_Screw:9
- Mate:282: 3DP_PLA_Fiberglass_Pipe_Corner_Bracket_Clamp:2 ↔ COTS_DREMEC_8G206M6X50_M6x50_Nylon_Screw:13
- Mate:283: 3DP_PLA_Fiberglass_Pipe_Corner_Bracket_Clamp:2 ↔ COTS_DREMEC_8G206M6X50_M6x50_Nylon_Screw:16
- Mate:284: 3DP_PLA_Fiberglass_Pipe_Corner_Bracket_Clamp:2 ↔ COTS_DREMEC_8G206M6X50_M6x50_Nylon_Screw:15
- Mate:285: 3DP_PLA_Fiberglass_Pipe_Corner_Bracket_Clamp:2 ↔ COTS_DREMEC_8G206M6X50_M6x50_Nylon_Screw:14
- Mate:286: 3DP_PLA_Fiberglass_Pipe_Corner_Bracket_Clamp:2 ↔ COTS_DREMEC_8G206M6X50_M6x50_Nylon_Screw:17
- Mate:287: 3DP_PLA_Fiberglass_Pipe_Corner_Bracket_Clamp:2 ↔ COTS_DREMEC_8G206M6X50_M6x50_Nylon_Screw:18
- Mate:288: 3DP_PLA_Fiberglass_Pipe_Corner_Bracket_Clamp:3 ↔ COTS_DREMEC_8G206M6X50_M6x50_Nylon_Screw:19
- Mate:289: 3DP_PLA_Fiberglass_Pipe_Corner_Bracket_Clamp:3 ↔ COTS_DREMEC_8G206M6X50_M6x50_Nylon_Screw:20
- Mate:290: 3DP_PLA_Fiberglass_Pipe_Corner_Bracket_Clamp:3 ↔ COTS_DREMEC_8G206M6X50_M6x50_Nylon_Screw:22
- Mate:291: 3DP_PLA_Fiberglass_Pipe_Corner_Bracket_Clamp:3 ↔ COTS_DREMEC_8G206M6X50_M6x50_Nylon_Screw:21
- Mate:292: 3DP_PLA_Fiberglass_Pipe_Corner_Bracket_Clamp:3 ↔ COTS_DREMEC_8G206M6X50_M6x50_Nylon_Screw:23
- Mate:293: 3DP_PLA_Fiberglass_Pipe_Corner_Bracket_Clamp:3 ↔ COTS_DREMEC_8G206M6X50_M6x50_Nylon_Screw:24
- Mate:294: 3DP_PLA_Fiberglass_Pipe_Corner_Bracket_Clamp:3 ↔ COTS_DREMEC_8G206M6X50_M6x50_Nylon_Screw:22
- Mate:295: 3DP_PLA_Fiberglass_Pipe_Corner_Bracket_Clamp:3 ↔ COTS_DREMEC_8G206M6X50_M6x50_Nylon_Screw:20
- Mate:296: 3DP_PLA_Fiberglass_Pipe_Corner_Bracket_Clamp:3 ↔ COTS_DREMEC_8G206M6X50_M6x50_Nylon_Screw:19
- Mate:297: 3DP_PLA_Fiberglass_Pipe_Corner_Bracket_Clamp:3 ↔ COTS_DREMEC_8G206M6X50_M6x50_Nylon_Screw:23
- Mate:298: 3DP_PLA_Fiberglass_Pipe_Corner_Bracket_Clamp:3 ↔ COTS_DREMEC_8G206M6X50_M6x50_Nylon_Screw:21
- Mate:299: 3DP_PLA_Fiberglass_Pipe_Corner_Bracket_Clamp:3 ↔ COTS_DREMEC_8G206M6X50_M6x50_Nylon_Screw:24
- Mate:300: 3DP_PLA_Fiberglass_Pipe_Corner_Bracket_Clamp:2 ↔ COTS_DREMEC_8G206M6X50_M6x50_Nylon_Screw:17
- Mate:301: 3DP_PLA_Fiberglass_Pipe_Corner_Bracket_Clamp:2 ↔ COTS_DREMEC_8G206M6X50_M6x50_Nylon_Screw:18
- Mate:302: 3DP_PLA_Fiberglass_Pipe_Corner_Bracket_Clamp:2 ↔ COTS_DREMEC_8G206M6X50_M6x50_Nylon_Screw:16
- Mate:303: 3DP_PLA_Fiberglass_Pipe_Corner_Bracket_Clamp:2 ↔ COTS_DREMEC_8G206M6X50_M6x50_Nylon_Screw:14
- Mate:304: 3DP_PLA_Fiberglass_Pipe_Corner_Bracket_Clamp:2 ↔ COTS_DREMEC_8G206M6X50_M6x50_Nylon_Screw:13
- Mate:305: 3DP_PLA_Fiberglass_Pipe_Corner_Bracket_Clamp:2 ↔ COTS_DREMEC_8G206M6X50_M6x50_Nylon_Screw:15
- Mate:306: 3DP_PLA_Fiberglass_Pipe_Corner_Bracket:2 ↔ COTS_BOSSARD_1400444_M6_Nylon_Nut:13
- Mate:307: 3DP_PLA_Fiberglass_Pipe_Corner_Bracket:2 ↔ COTS_BOSSARD_1400444_M6_Nylon_Nut:14
- Mate:308: 3DP_PLA_Fiberglass_Pipe_Corner_Bracket:2 ↔ COTS_BOSSARD_1400444_M6_Nylon_Nut:18
- Mate:309: 3DP_PLA_Fiberglass_Pipe_Corner_Bracket:2 ↔ COTS_BOSSARD_1400444_M6_Nylon_Nut:16
- Mate:310: 3DP_PLA_Fiberglass_Pipe_Corner_Bracket:2 ↔ COTS_BOSSARD_1400444_M6_Nylon_Nut:17
- Mate:311: 3DP_PLA_Fiberglass_Pipe_Corner_Bracket:2 ↔ COTS_BOSSARD_1400444_M6_Nylon_Nut:15
- Mate:312: 3DP_PLA_Fiberglass_Pipe_Corner_Bracket:2 ↔ COTS_BOSSARD_1400444_M6_Nylon_Nut:19
- Mate:313: 3DP_PLA_Fiberglass_Pipe_Corner_Bracket:2 ↔ COTS_BOSSARD_1400444_M6_Nylon_Nut:20
- Mate:314: 3DP_PLA_Fiberglass_Pipe_Corner_Bracket:2 ↔ COTS_BOSSARD_1400444_M6_Nylon_Nut:21
- Mate:315: 3DP_PLA_Fiberglass_Pipe_Corner_Bracket:2 ↔ COTS_BOSSARD_1400444_M6_Nylon_Nut:22
- Mate:316: 3DP_PLA_Fiberglass_Pipe_Corner_Bracket:2 ↔ COTS_BOSSARD_1400444_M6_Nylon_Nut:23
- Mate:317: 3DP_PLA_Fiberglass_Pipe_Corner_Bracket:2 ↔ COTS_BOSSARD_1400444_M6_Nylon_Nut:24
- Mate:318: COTS_BOSSARD_1400444_M6_Nylon_Nut:14 ↔ COTS_DREMEC_8G206M6X50_M6x50_Nylon_Screw:17
- Mate:319: COTS_BOSSARD_1400444_M6_Nylon_Nut:13 ↔ COTS_DREMEC_8G206M6X50_M6x50_Nylon_Screw:15
- Mate:320: COTS_BOSSARD_1400444_M6_Nylon_Nut:15 ↔ COTS_DREMEC_8G206M6X50_M6x50_Nylon_Screw:18
- Mate:321: COTS_BOSSARD_1400444_M6_Nylon_Nut:18 ↔ COTS_DREMEC_8G206M6X50_M6x50_Nylon_Screw:16
- Mate:322: COTS_BOSSARD_1400444_M6_Nylon_Nut:17 ↔ COTS_DREMEC_8G206M6X50_M6x50_Nylon_Screw:14
- Mate:323: COTS_BOSSARD_1400444_M6_Nylon_Nut:16 ↔ COTS_DREMEC_8G206M6X50_M6x50_Nylon_Screw:13
- Mate:324: COTS_BOSSARD_1400444_M6_Nylon_Nut:19 ↔ COTS_DREMEC_8G206M6X50_M6x50_Nylon_Screw:24
- Mate:325: COTS_BOSSARD_1400444_M6_Nylon_Nut:20 ↔ COTS_DREMEC_8G206M6X50_M6x50_Nylon_Screw:19
- Mate:326: COTS_BOSSARD_1400444_M6_Nylon_Nut:22 ↔ COTS_DREMEC_8G206M6X50_M6x50_Nylon_Screw:20
- Mate:327: COTS_BOSSARD_1400444_M6_Nylon_Nut:21 ↔ COTS_DREMEC_8G206M6X50_M6x50_Nylon_Screw:23
- Mate:328: COTS_BOSSARD_1400444_M6_Nylon_Nut:24 ↔ COTS_DREMEC_8G206M6X50_M6x50_Nylon_Screw:21
- Mate:329: COTS_BOSSARD_1400444_M6_Nylon_Nut:23 ↔ COTS_DREMEC_8G206M6X50_M6x50_Nylon_Screw:22
- Mate:331: 3DP_PLA_Fiberglass_Pipe_Corner_Bracket_Clamp_and_B_axis_Stepper_Mount_REVB:1 ↔ ASSEMBLY_HTD3M_Idler_B_Axis:1
- Mate:332: 3DP_PLA_Fiberglass_Pipe_Corner_Bracket_Clamp_and_B_axis_Stepper_Mount_REVB:1 ↔ ASSEMBLY_HTD3M_Idler_B_Axis:2
- Mate:333: 3DP_PLA_Fiberglass_Pipe_Corner_Bracket_Clamp_and_B_axis_Stepper_Mount_REVB:1 ↔ ASSEMBLY_HTD3M_Idler_B_Axis:2
- Mate:334: 3DP_PLA_Fiberglass_Pipe_Corner_Bracket_Clamp_and_B_axis_Stepper_Mount_REVB:1 ↔ ASSEMBLY_HTD3M_Idler_B_Axis:1
- Mate:335: COTS_GENERIC_HTD3M_20T_6mm_5mm_shaft_pulley:1 ↔ COTS_GENERIC_HTD3M_6mm_1530mm_Closed_belt_B_Axis:1
- Mate:336 (6 mm): 3DP_PLA_Fiberglass_Pipe_Corner_Bracket_Clamp_and_B_axis_Stepper_Mount_REVB:1 ↔ COTS_MKS_SERVO42D_40mm:2
- Mate:337 (0.5 mm): COTS_GENERIC_HTD3M_20T_6mm_5mm_shaft_pulley:1 ↔ COTS_GENERIC_HTD3M_6mm_1530mm_Closed_belt_B_Axis:1
- Mate:339: 3DP_PLA_B_Axis_Main_Pulley:1 ↔ COTS_GENERIC_HTD3M_6mm_1530mm_Closed_belt_B_Axis:1
- Mate:340 (0.5 mm): 3DP_PLA_B_Axis_Main_Pulley:1 ↔ COTS_GENERIC_HTD3M_6mm_1530mm_Closed_belt_B_Axis:1
- Mate:341: COTS_MKS_SERVO42D_40mm:2 ↔ DIN 125-1 A A 3,2:5
- Mate:342: 3DP_PLA_Fiberglass_Pipe_Corner_Bracket_Clamp_and_B_axis_Stepper_Mount_REVB:1 ↔ DIN 125-1 A A 3,2:5
- Mate:343: COTS_MKS_SERVO42D_40mm:2 ↔ DIN 125-1 A A 3,2:6
- Mate:344: 3DP_PLA_Fiberglass_Pipe_Corner_Bracket_Clamp_and_B_axis_Stepper_Mount_REVB:1 ↔ DIN 125-1 A A 3,2:6
- Mate:345: COTS_MKS_SERVO42D_40mm:2 ↔ DIN 125-1 A A 3,2:7
- Mate:346: 3DP_PLA_Fiberglass_Pipe_Corner_Bracket_Clamp_and_B_axis_Stepper_Mount_REVB:1 ↔ DIN 125-1 A A 3,2:7
- Mate:347: COTS_MKS_SERVO42D_40mm:2 ↔ DIN 125-1 A A 3,2:8
- Mate:348: 3DP_PLA_Fiberglass_Pipe_Corner_Bracket_Clamp_and_B_axis_Stepper_Mount_REVB:1 ↔ DIN 125-1 A A 3,2:8
- Insert:5: ISO 7380-1 M3 x 16:5 ↔ DIN 125-1 A A 3,2:5
- Insert:6: ISO 7380-1 M3 x 16:6 ↔ DIN 125-1 A A 3,2:6
- Insert:7: ISO 7380-1 M3 x 16:7 ↔ DIN 125-1 A A 3,2:7
- Insert:8: ISO 7380-1 M3 x 16:8 ↔ DIN 125-1 A A 3,2:8
- Angle:42 (90 deg): COTS_CARBONCENTER_Fiberglass_Tube_27x24x383mm:3 ↔ COTS_GENERIC_HTD3M_6mm_1530mm_Closed_belt_B_Axis:1
- Mate:357: 3DP_PLA_B_Axis_Main_Pulley:1 ↔ COTS_GENERIC_6016_80x125x22mm_POM_Ball_Bearing:1
- Mate:358: 3DP_PLA_B_Axis_Main_Pulley:1 ↔ COTS_GENERIC_6016_80x125x22mm_POM_Ball_Bearing:1
- Mate:359: 3DP_PLA_B_Axis_Main_Pulley:1 ↔ COTS_GENERIC_6016_80x125x22mm_POM_Ball_Bearing:2
- Mate:360: 3DP_PLA_B_Axis_Main_Pulley:1 ↔ COTS_GENERIC_6016_80x125x22mm_POM_Ball_Bearing:2
- Mate:361: COTS_GENERIC_6016_80x125x22mm_POM_Ball_Bearing:2 ↔ 3DP_PLA_B_Axis_Bearing_Mounting_Plate:1
- Flush:16: COTS_GENERIC_6016_80x125x22mm_POM_Ball_Bearing:2 ↔ 3DP_PLA_B_Axis_Bearing_Mounting_Plate:1
- Angle:43 (0 deg): 3DP_PLA_Fiberglass_Pipe_Corner_Bracket_Clamp_and_B_axis_Stepper_Mount_REVB:1 ↔ 3DP_PLA_B_Axis_Bearing_Mounting_Plate:1
- Flush:17: COTS_GENERIC_6016_80x125x22mm_POM_Ball_Bearing:1 ↔ 3DP_PLA_B_Axis_Bearing_Mounting_Plate:2
- Mate:362: COTS_GENERIC_6016_80x125x22mm_POM_Ball_Bearing:1 ↔ 3DP_PLA_B_Axis_Bearing_Mounting_Plate:2
- Flush:18: 3DP_PLA_B_Axis_Bearing_Mounting_Plate:1 ↔ 3DP_PLA_B_Axis_Bearing_Mounting_Plate:2
- Mate:363: 3DP_PLA_B_Axis_Bearing_Mounting_Plate:1 ↔ ASSEMBLY_HTD3M_Idler_B_Axis_Top:1
- Mate:364: 3DP_PLA_B_Axis_Bearing_Mounting_Plate:1 ↔ ASSEMBLY_HTD3M_Idler_B_Axis_Top:2
- Mate:365: 3DP_PLA_B_Axis_Bearing_Mounting_Plate:1 ↔ ASSEMBLY_HTD3M_Idler_B_Axis_Top:1
- Mate:366: 3DP_PLA_B_Axis_Bearing_Mounting_Plate:1 ↔ ASSEMBLY_HTD3M_Idler_B_Axis_Top:2
- Mate:367: 3DP_PLA_B_Axis_Bearing_Mounting_Plate:1 ↔ COTS_DREMEC_8G206V50126_M4x40_Screw:1
- Mate:368: 3DP_PLA_B_Axis_Bearing_Mounting_Plate:1 ↔ COTS_DREMEC_8G206V50126_M4x40_Screw:2
- Mate:369: 3DP_PLA_B_Axis_Bearing_Mounting_Plate:1 ↔ COTS_DREMEC_8G206V50126_M4x40_Screw:2
- Mate:370: 3DP_PLA_B_Axis_Bearing_Mounting_Plate:1 ↔ COTS_DREMEC_8G206V50126_M4x40_Screw:1
- Mate:371: 3DP_PLA_B_Axis_Bearing_Mounting_Plate:2 ↔ COTS_DREMEC_8G206M6X50_M6x50_Nylon_Screw:25
- Mate:372: 3DP_PLA_B_Axis_Bearing_Mounting_Plate:2 ↔ COTS_DREMEC_8G206M6X50_M6x50_Nylon_Screw:26
- Mate:373: 3DP_PLA_B_Axis_Bearing_Mounting_Plate:2 ↔ COTS_DREMEC_8G206M6X50_M6x50_Nylon_Screw:27
- Mate:374: 3DP_PLA_B_Axis_Bearing_Mounting_Plate:2 ↔ COTS_DREMEC_8G206M6X50_M6x50_Nylon_Screw:28
- Mate:375: 3DP_PLA_B_Axis_Bearing_Mounting_Plate:2 ↔ COTS_DREMEC_8G206M6X50_M6x50_Nylon_Screw:29
- Mate:376: 3DP_PLA_B_Axis_Bearing_Mounting_Plate:2 ↔ COTS_DREMEC_8G206M6X50_M6x50_Nylon_Screw:30
- Mate:377: 3DP_PLA_B_Axis_Bearing_Mounting_Plate:2 ↔ COTS_DREMEC_8G206M6X50_M6x50_Nylon_Screw:26
- Mate:378: 3DP_PLA_B_Axis_Bearing_Mounting_Plate:2 ↔ COTS_DREMEC_8G206M6X50_M6x50_Nylon_Screw:28
- Mate:379: 3DP_PLA_B_Axis_Bearing_Mounting_Plate:2 ↔ COTS_DREMEC_8G206M6X50_M6x50_Nylon_Screw:30
- Mate:380: 3DP_PLA_B_Axis_Bearing_Mounting_Plate:2 ↔ COTS_DREMEC_8G206M6X50_M6x50_Nylon_Screw:27
- Mate:381: 3DP_PLA_B_Axis_Bearing_Mounting_Plate:2 ↔ COTS_DREMEC_8G206M6X50_M6x50_Nylon_Screw:25
- Mate:382: 3DP_PLA_B_Axis_Bearing_Mounting_Plate:2 ↔ COTS_DREMEC_8G206M6X50_M6x50_Nylon_Screw:29
- Mate:383: 3DP_PLA_B_Axis_Bearing_Mounting_Plate:1 ↔ COTS_BOSSARD_1400444_M6_Nylon_Nut:25
- Mate:384: 3DP_PLA_B_Axis_Bearing_Mounting_Plate:1 ↔ COTS_BOSSARD_1400444_M6_Nylon_Nut:27
- Mate:385: 3DP_PLA_B_Axis_Bearing_Mounting_Plate:1 ↔ COTS_BOSSARD_1400444_M6_Nylon_Nut:29
- Mate:386: 3DP_PLA_B_Axis_Bearing_Mounting_Plate:1 ↔ COTS_BOSSARD_1400444_M6_Nylon_Nut:30
- Mate:387: 3DP_PLA_B_Axis_Bearing_Mounting_Plate:1 ↔ COTS_BOSSARD_1400444_M6_Nylon_Nut:28
- Mate:388: 3DP_PLA_B_Axis_Bearing_Mounting_Plate:1 ↔ COTS_BOSSARD_1400444_M6_Nylon_Nut:26
- Mate:389: COTS_BOSSARD_1400444_M6_Nylon_Nut:25 ↔ COTS_DREMEC_8G206M6X50_M6x50_Nylon_Screw:28
- Mate:390: COTS_BOSSARD_1400444_M6_Nylon_Nut:28 ↔ COTS_DREMEC_8G206M6X50_M6x50_Nylon_Screw:26
- Mate:391: COTS_BOSSARD_1400444_M6_Nylon_Nut:27 ↔ COTS_DREMEC_8G206M6X50_M6x50_Nylon_Screw:27
- Mate:392: COTS_BOSSARD_1400444_M6_Nylon_Nut:30 ↔ COTS_DREMEC_8G206M6X50_M6x50_Nylon_Screw:30
- Mate:393: COTS_BOSSARD_1400444_M6_Nylon_Nut:29 ↔ COTS_DREMEC_8G206M6X50_M6x50_Nylon_Screw:25
- Mate:394: COTS_BOSSARD_1400444_M6_Nylon_Nut:26 ↔ COTS_DREMEC_8G206M6X50_M6x50_Nylon_Screw:29
- Mate:395: 3DP_PLA_B_Axis_Bearing_Mounting_Plate:2 ↔ COTS_DREMEC_8G206M6X50_M6x50_Nylon_Screw:31
- Mate:396: 3DP_PLA_B_Axis_Bearing_Mounting_Plate:2 ↔ COTS_DREMEC_8G206M6X50_M6x50_Nylon_Screw:31
- Mate:397: 3DP_PLA_B_Axis_Bearing_Mounting_Plate:1 ↔ COTS_BOSSARD_1400444_M6_Nylon_Nut:31
- Mate:398: COTS_BOSSARD_1400444_M6_Nylon_Nut:31 ↔ COTS_DREMEC_8G206M6X50_M6x50_Nylon_Screw:31
- Mate:399: 3DP_PLA_B_Axis_Bearing_Mounting_Plate:2 ↔ COTS_BOSSARD_1400428_M4_Nylon_Nut:1
- Mate:400: 3DP_PLA_B_Axis_Bearing_Mounting_Plate:2 ↔ COTS_BOSSARD_1400428_M4_Nylon_Nut:2
- Mate:401: COTS_BOSSARD_1400428_M4_Nylon_Nut:1 ↔ COTS_DREMEC_8G206V50126_M4x40_Screw:1
- Mate:402: COTS_BOSSARD_1400428_M4_Nylon_Nut:2 ↔ COTS_DREMEC_8G206V50126_M4x40_Screw:2
- Mate:403: COTS_GENERIC_6016_80x125x22mm_POM_Ball_Bearing:2 ↔ 3DP_PLA_B_Axis_Rotating_Stage:1
- Mate:404: 3DP_PLA_B_Axis_Main_Pulley:1 ↔ 3DP_PLA_B_Axis_Rotating_Stage:1
- Mate:405: COTS_CARBONCENTER_Fiberglass_Tube_27x24x383mm:6 ↔ 3DP_PLA_B_Axis_Rotating_Stage:1
- Mate:406: COTS_CARBONCENTER_Fiberglass_Tube_27x24x383mm:5 ↔ 3DP_PLA_B_Axis_Rotating_Stage:1
- Flush:19 (-130 mm): COTS_CARBONCENTER_Fiberglass_Tube_27x24x383mm:5 ↔ 3DP_PLA_B_Axis_Rotating_Stage:1
- Mate:407: COTS_CARBONCENTER_Fiberglass_Tube_27x24x383mm:5 ↔ 3DP_PLA_B_Axis_Rotating_Stage_Fiberglass_pipes_mount_clamp:1
- Mate:408: COTS_CARBONCENTER_Fiberglass_Tube_27x24x383mm:6 ↔ 3DP_PLA_B_Axis_Rotating_Stage_Fiberglass_pipes_mount_clamp:1
- Flush:20: 3DP_PLA_B_Axis_Rotating_Stage:1 ↔ 3DP_PLA_B_Axis_Rotating_Stage_Fiberglass_pipes_mount_clamp:1
- Mate:409: COTS_CARBONCENTER_Fiberglass_Tube_27x24x383mm:5 ↔ 3DP_PLA_B_Axis_Rotating_Stage_Fiberglass_pipes_mount_clamp:2
- Mate:410: COTS_CARBONCENTER_Fiberglass_Tube_27x24x383mm:6 ↔ 3DP_PLA_B_Axis_Rotating_Stage_Fiberglass_pipes_mount_clamp:2
- Flush:21: 3DP_PLA_B_Axis_Rotating_Stage:1 ↔ 3DP_PLA_B_Axis_Rotating_Stage_Fiberglass_pipes_mount_clamp:2
- Mate:411: COTS_CARBONCENTER_Fiberglass_Tube_27x24x383mm:4 ↔ 3DP_PLA_B_Axis_Bearing_Mounting_Plate:1